# Autodesk Inventor assembly: Z-Axis
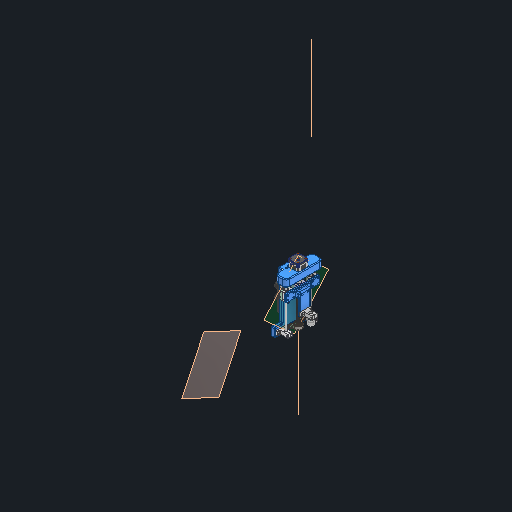
[picture p0: Inventor's stored thumbnail of the model, 512x512]
Saved by Autodesk Inventor 2027.1 (Build 311270010, 270A)
## iProperties
Created: 2026-10-04
Part Number: Z-Axis
Document SubType Name: Assembly
Designer: Ahmed
Author: Ahmed
## Documents named in this file (29)
- C:\Users\Ahmed\Desktop\Fall 26\Design 1 Repo\MCT333_Design_of_Mechatronics_Systems_1\CAD\cartesian_robot_workspace\Z Axis\Z-Axis.iam
- C:\Users\Ahmed\Desktop\Fall 26\Design 1 Repo\MCT333_Design_of_Mechatronics_Systems_1\CAD\cartesian_robot_workspace\Z Axis\V-Pulley.ipt
- C:\Users\Ahmed\Desktop\Fall 26\Design 1 Repo\MCT333_Design_of_Mechatronics_Systems_1\CAD\cartesian_robot_workspace\Z Axis\VSoltGantrySetAllSizes\VSoltGantrySetAllSizes\40mm Gantry Set universal\127x88 Gantry.ipt
- C:\Users\Ahmed\Desktop\Fall 26\Design 1 Repo\MCT333_Design_of_Mechatronics_Systems_1\CAD\cartesian_robot_workspace\Z Axis\sk8-linear-shaft-support-8mm-1.snapshot.1\SK8 Linear Shaft Support, 8mm v4\SK8 Linear Shaft Support, 8mm v4.ipt
- C:\Users\Ahmed\Desktop\Fall 26\Design 1 Repo\MCT333_Design_of_Mechatronics_Systems_1\CAD\cartesian_robot_workspace\Z Axis\scs8uu-linear-bearing-block-8mm-shaft-1.snapshot.1\SCS8UU Block, Linear Bearing, 8mm Shaft v4\SCS8UU Block, Linear Bearing, 8mm.ipt
- C:\Users\Ahmed\Desktop\Fall 26\Design 1 Repo\MCT333_Design_of_Mechatronics_Systems_1\CAD\cartesian_robot_workspace\Z Axis\shf10-shf8-linear-shaft-support-1.snapshot.6\SHF8\SHF8.ipt
- C:\Users\Ahmed\Desktop\Fall 26\Design 1 Repo\MCT333_Design_of_Mechatronics_Systems_1\CAD\cartesian_robot_workspace\Z Axis\KP08 Pillow block bearing 08mm diameter\KP08 Pillow block bearing 08mm diameter.ipt
- C:\Users\Ahmed\Desktop\Fall 26\Design 1 Repo\MCT333_Design_of_Mechatronics_Systems_1\CAD\cartesian_robot_workspace\Z Axis\nema-17-40mm-stepper-motor-1.snapshot.22\17HM15-0904S\17HM15-0904S\17HM15-0904S.ipt
- C:\Users\Ahmed\Desktop\Fall 26\Design 1 Repo\MCT333_Design_of_Mechatronics_Systems_1\CAD\cartesian_robot_workspace\Z Axis\aluminum-flexible-shaft-coupling-5mm-x-8mm-1.snapshot.1\Flexible Shaft Coupling 5mm to 8mm\Flexible_Shaft_Coupling_5_to_8mm v7.ipt
- C:\Users\Ahmed\Desktop\Fall 26\Design 1 Repo\MCT333_Design_of_Mechatronics_Systems_1\CAD\cartesian_robot_workspace\Z Axis\Z Bracket.ipt
- C:\Users\Ahmed\Desktop\Fall 26\Design 1 Repo\MCT333_Design_of_Mechatronics_Systems_1\CAD\cartesian_robot_workspace\Z Axis\tr8x8-4-8mm-4-start-lead-screw-1.snapshot.6\Trapezoidal lead screw tr8x8-4\Trapezoidal lead screw tr8x8-4.ipt
- C:\Users\Ahmed\Desktop\Fall 26\Design 1 Repo\MCT333_Design_of_Mechatronics_Systems_1\CAD\cartesian_robot_workspace\Z Axis\t8_nut_housing\t8_nut_housing.ipt
- C:\Users\Ahmed\Desktop\Fall 26\Design 1 Repo\MCT333_Design_of_Mechatronics_Systems_1\CAD\cartesian_robot_workspace\Z Axis\shf10-shf8-linear-shaft-support-1.snapshot.6\SHF8\SHF8_MIR.ipt
- C:\Users\Ahmed\Desktop\Fall 26\Design 1 Repo\MCT333_Design_of_Mechatronics_Systems_1\CAD\cartesian_robot_workspace\Z Axis\Linear Guide Rods.ipt
- C:\Users\Ahmed\Documents\Inventor\Content Center Files\R2027\en-US\ISO 4032(2)\ISO 4032 - M5 - ISO.ipt
- C:\Users\Ahmed\Documents\Inventor\Content Center Files\R2027\en-US\ISO 4762(2)\ISO 4762 - M5 x 16ISO.ipt
- C:\Users\Ahmed\Desktop\Fall 26\Design 1 Repo\MCT333_Design_of_Mechatronics_Systems_1\CAD\cartesian_robot_workspace\Z Axis\Bearing Spacer.ipt
- C:\Users\Ahmed\Desktop\Fall 26\Design 1 Repo\MCT333_Design_of_Mechatronics_Systems_1\CAD\cartesian_robot_workspace\Z Axis\Insert M5 D7 L9.5mm\Insert M5 D7 L9.5mm.ipt
- C:\Users\Ahmed\Desktop\Fall 26\Design 1 Repo\MCT333_Design_of_Mechatronics_Systems_1\CAD\cartesian_robot_workspace\Z Axis\M4 Insert\M4 Insert.ipt
- C:\Users\Ahmed\Documents\Inventor\Content Center Files\R2027\en-US\ISO 4762(2)\ISO 4762 - M5 x 20ISO.ipt
- C:\Users\Ahmed\Desktop\Fall 26\Design 1 Repo\MCT333_Design_of_Mechatronics_Systems_1\CAD\cartesian_robot_workspace\Z Axis\ISO 4762 - M5 x 16ISO.ipt
- C:\Users\Ahmed\Desktop\Fall 26\Design 1 Repo\MCT333_Design_of_Mechatronics_Systems_1\CAD\cartesian_robot_workspace\Z Axis\Linear Bearing Spacer.ipt
- C:\Users\Ahmed\Desktop\Fall 26\Design 1 Repo\MCT333_Design_of_Mechatronics_Systems_1\CAD\cartesian_robot_workspace\Z Axis\T8 nut\T8 nut.ipt
- C:\Users\Ahmed\Documents\Inventor\Content Center Files\R2027\en-US\ISO 4762(2)\ISO 4762 - M3 x 12ISO.ipt
- C:\Users\Ahmed\Desktop\Fall 26\Design 1 Repo\MCT333_Design_of_Mechatronics_Systems_1\CAD\cartesian_robot_workspace\Z Axis\NO-NC Bump Switch\NO-NC Bump Switch.ipt
- C:\Users\Ahmed\Desktop\Fall 26\Design 1 Repo\MCT333_Design_of_Mechatronics_Systems_1\CAD\cartesian_robot_workspace\Z Axis\Limit Switch Spacer.ipt
- C:\Users\Ahmed\Desktop\Fall 26\Design 1 Repo\MCT333_Design_of_Mechatronics_Systems_1\CAD\cartesian_robot_workspace\Z Axis\SK12 SHAFT HOLDER\SK12 SHAFT HOLDER.ipt
- C:\Users\Ahmed\Desktop\Fall 26\Design 1 Repo\MCT333_Design_of_Mechatronics_Systems_1\CAD\cartesian_robot_workspace\Z Axis\Suction Cup Fixation.ipt
- C:\Users\Ahmed\Desktop\Fall 26\Design 1 Repo\MCT333_Design_of_Mechatronics_Systems_1\CAD\cartesian_robot_workspace\Z Axis\Suction\Suction.iam
## Components (70 placed, 27 different names)
1. 127x88 Gantry:1 — Insert:2, Insert:4, Mate:2, Mate:3, Mate:4, Insert:27, Insert:28, Mate:89, Mate:93, Mate:94, Mate:95, Mate:97, Mate:98, Mate:99, Mate:100, Flush:18, Flush:19, Flush:20
2. V-Pulley:4 — Insert:27
3. V-Pulley:3 — Insert:28
4. V-Pulley:2 — Insert:4
5. V-Pulley:1 — Insert:2
6. ISO 4032 M5:13 — Mate:96, Mate:97
7. ISO 4032 M5:20 — Mate:98, Mate:102
8. ISO 4032 M5:19 — Mate:99, Mate:101
9. ISO 4032 M5:18 — Mate:100, Mate:103
10. ISO 4762 M5 x 20:9 — Insert:29, Mate:96
11. ISO 4762 M5 x 20:12 — Insert:32, Mate:101
12. ISO 4762 M5 x 20:10 — Insert:31, Mate:102
13. ISO 4762 M5 x 20:11 — Insert:30, Mate:103
14. ISO 4032 M5:17 — Mate:88, Mate:89
15. ISO 4032 M5:16 — Mate:90, Mate:95
16. ISO 4032 M5:15 — Mate:91, Mate:94
17. ISO 4032 M5:14 — Mate:92, Mate:93
18. ISO 4762 M5 x 20:7 — Insert:17, Mate:92
19. ISO 4762 M5 x 20:8 — Insert:18, Mate:91
20. ISO 4762 M5 x 20:5 — Insert:15, Mate:88
21. ISO 4762 M5 x 20:6 — Insert:16, Mate:90
22. Z Bracket:1 — Mate:2, Mate:3, Mate:4, Mate:7, Mate:10, Angle:1, Mate:18, Mate:19, Mate:20, Mate:21, Mate:22, Mate:26, Mate:27, Mate:28, Mate:30, Mate:32, Angle:6, Mate:38, Angle:7, Mate:41, Mate:42, Mate:43, Mate:44, Mate:45, Mate:47, Mate:48, Mate:49, Mate:50, Mate:51, Mate:52, Mate:53, Flush:7, Mate:54, Flush:8, Mate:55, Flush:9, Mate:56, Flush:10, Mate:57, Mate:58, Mate:59, Mate:60, Flush:11, Flush:12, Flush:13, Flush:14, Mate:61, Mate:62, Flush:15, Flush:16, Insert:15, Insert:16, Insert:17, Insert:18, Insert:23, Insert:24, Insert:25, Insert:26, Insert:29, Insert:30, Insert:31, Insert:32, Flush:17, Mate:104, Mate:105, Mate:106, Mate:116, Mate:117
23. Bearing Spacer:1 — Mate:50, Mate:51, Mate:52
24. Insert M5 D7 L9.5mm:1 — Mate:53, Flush:7
25. Insert M5 D7 L9.5mm:2 — Mate:54, Flush:8
26. Insert M5 D7 L9.5mm:3 — Mate:55, Flush:9
27. Insert M5 D7 L9.5mm:4 — Mate:56, Flush:10
28. Insert M5 D7 L9.5mm:5 — Mate:58, Flush:13
29. Insert M5 D7 L9.5mm:6 — Mate:57, Flush:14
30. Insert M5 D7 L9.5mm:7 — Mate:59, Flush:11
31. Insert M5 D7 L9.5mm:8 — Mate:60, Flush:12
32. M4 Insert:1 — Mate:61, Flush:16
33. M4 Insert:2 — Mate:62, Flush:15
34. 17HM15-0904S:1 — Mate:7, Mate:8, Mate:116, Mate:117
35. Flexible_Shaft_Coupling_5_to_8mm v7:1 — Mate:8, Mate:10, Mate:12, Mate:33, Mate:63, Tangent:13
36. ISO 4762 M5 x 16:5 — Insert:23
37. ISO 4762 M5 x 16:6 — Insert:24
38. ISO 4762 M5 x 16:7 — Insert:25
39. ISO 4762 M5 x 16:8 — Insert:26
40. Linear Bearing Spacer:2 — Mate:75, Mate:76, Mate:77, Mate:108
41. SCS8UU Block, Linear Bearing, 8mm:2 — Mate:35, Angle:4, Flush:6, Mate:75, Mate:76, Mate:77
42. SK8 Linear Shaft Support, 8mm v4:1 — Mate:18, Mate:29, Mate:41, Mate:42, Insert:9, Insert:10
43. SHF8:1 — Mate:19, Mate:20, Mate:21, Mate:22, Insert:5, Insert:6
44. Linear Guide Rods:2 — Mate:29, Mate:30, Mate:35
45. ISO 4762 M5 x 20:1 — Insert:5
46. ISO 4762 M5 x 20:2 — Insert:6
47. ISO 4762 M5 x 16:1 — Insert:9
48. ISO 4762 M5 x 16:2 — Insert:10
49. KP08 Pillow block bearing 08mm diameter:1 — Mate:47, Mate:48, Mate:49, Insert:13, Insert:14
50. Trapezoidal lead screw tr8x8-4:1 — Mate:12, Mate:13, Mate:33
51. t8_nut_housing:1 — Mate:13, Angle:1, Angle:4, Angle:5, Flush:5, Flush:6, Mate:63, Mate:81, Mate:82, Mate:83, Mate:107, Mate:109
52. ISO 4762 M5 x 16:1 — Insert:13
53. ISO 4762 M5 x 16:2 — Insert:14
54. T8 nut:1 — Mate:81, Mate:82, Mate:83, Mate:84, Mate:85, Mate:86, Mate:87
55. ISO 4762 M3 x 12:4 — Mate:84, Mate:87
56. ISO 4762 M3 x 12:5 — Mate:85, Mate:86
57. SCS8UU Block, Linear Bearing, 8mm:1 — Mate:34, Angle:5, Flush:5, Mate:78, Mate:79, Mate:80
58. SHF8_MIR:1 — Mate:26, Mate:27, Mate:28, Insert:7, Insert:8
59. Linear Guide Rods:1 — Mate:32, Mate:34, Mate:36, Mate:46
60. SK8 Linear Shaft Support, 8mm v4:2 — Mate:43, Mate:44, Mate:45, Mate:46, Insert:11, Insert:12
61. ISO 4762 M5 x 20:3 — Insert:7
62. ISO 4762 M5 x 20:4 — Insert:8
63. ISO 4762 M5 x 16:3 — Insert:12
64. ISO 4762 M5 x 16:4 — Insert:11
65. Linear Bearing Spacer:1 — Mate:78, Mate:79, Mate:80
66. NO-NC Bump Switch:1 — Tangent:13, Flush:17, Mate:115
67. Limit Switch Spacer:1 — Mate:104, Mate:105, Mate:106, Mate:115
68. Suction:1 [sub-assembly] — Mate:118, Mate:119
69. SK12 SHAFT HOLDER:1 — Mate:110, Mate:111, Mate:112, Mate:118, Mate:119
70. Suction Cup Fixation:1 — Mate:107, Mate:108, Mate:109, Mate:110, Mate:111, Mate:112
## Relationships (140: Mate 92, Insert 26, Flush 16, Angle 5, Tangent 1)
- Insert:2: 127x88 Gantry:1 ↔ V-Pulley:1
- Insert:4: 127x88 Gantry:1 ↔ V-Pulley:2
- Mate:2: 127x88 Gantry:1 ↔ Z Bracket:1
- Mate:3: 127x88 Gantry:1 ↔ Z Bracket:1
- Mate:4: 127x88 Gantry:1 ↔ Z Bracket:1
- Mate:7: Z Bracket:1 ↔ 17HM15-0904S:1
- Mate:8: 17HM15-0904S:1 ↔ Flexible_Shaft_Coupling_5_to_8mm v7:1
- Mate:10: Z Bracket:1 ↔ Flexible_Shaft_Coupling_5_to_8mm v7:1
- Mate:12: Flexible_Shaft_Coupling_5_to_8mm v7:1 ↔ Trapezoidal lead screw tr8x8-4:1
- Mate:13: Trapezoidal lead screw tr8x8-4:1 ↔ t8_nut_housing:1
- Angle:1 (0 deg): Z Bracket:1 ↔ t8_nut_housing:1
- Mate:18: Z Bracket:1 ↔ SK8 Linear Shaft Support, 8mm v4:1
- Mate:19: Z Bracket:1 ↔ SHF8:1
- Mate:20: Z Bracket:1 ↔ SHF8:1
- Mate:21: Z Bracket:1 ↔ SHF8:1
- Mate:22: Z Bracket:1 ↔ SHF8:1
- Mate:26: Z Bracket:1 ↔ SHF8_MIR:1
- Mate:27: Z Bracket:1 ↔ SHF8_MIR:1
- Mate:28: Z Bracket:1 ↔ SHF8_MIR:1
- Mate:29: SK8 Linear Shaft Support, 8mm v4:1 ↔ Linear Guide Rods:2
- Mate:30: Z Bracket:1 ↔ Linear Guide Rods:2
- Mate:32: Z Bracket:1 ↔ Linear Guide Rods:1
- Mate:33: Flexible_Shaft_Coupling_5_to_8mm v7:1 ↔ Trapezoidal lead screw tr8x8-4:1
- Mate:34: SCS8UU Block, Linear Bearing, 8mm:1 ↔ Linear Guide Rods:1
- Mate:35: SCS8UU Block, Linear Bearing, 8mm:2 ↔ Linear Guide Rods:2
- Angle:4 (0 deg): SCS8UU Block, Linear Bearing, 8mm:2 ↔ t8_nut_housing:1
- Angle:5 (0 deg): t8_nut_housing:1 ↔ SCS8UU Block, Linear Bearing, 8mm:1
- Mate:36: Linear Guide Rods:1
- Mate:37
- Angle:6 (90 deg): Z Bracket:1
- Mate:38: Z Bracket:1
- Mate:39
- Angle:7 (90 deg): Z Bracket:1
- Flush:5: t8_nut_housing:1 ↔ SCS8UU Block, Linear Bearing, 8mm:1
- Flush:6: SCS8UU Block, Linear Bearing, 8mm:2 ↔ t8_nut_housing:1
- Mate:41: Z Bracket:1 ↔ SK8 Linear Shaft Support, 8mm v4:1
- Mate:42: Z Bracket:1 ↔ SK8 Linear Shaft Support, 8mm v4:1
- Mate:43: Z Bracket:1 ↔ SK8 Linear Shaft Support, 8mm v4:2
- Mate:44: Z Bracket:1 ↔ SK8 Linear Shaft Support, 8mm v4:2
- Mate:45: Z Bracket:1 ↔ SK8 Linear Shaft Support, 8mm v4:2
- Mate:46: Linear Guide Rods:1 ↔ SK8 Linear Shaft Support, 8mm v4:2
- Mate:47: Z Bracket:1 ↔ KP08 Pillow block bearing 08mm diameter:1
- Mate:48: Z Bracket:1 ↔ KP08 Pillow block bearing 08mm diameter:1
- Mate:49: Z Bracket:1 ↔ KP08 Pillow block bearing 08mm diameter:1
- Mate:50: Z Bracket:1 ↔ Bearing Spacer:1
- Mate:51: Z Bracket:1 ↔ Bearing Spacer:1
- Mate:52: Z Bracket:1 ↔ Bearing Spacer:1
- Mate:53: Z Bracket:1 ↔ Insert M5 D7 L9.5mm:1
- Flush:7: Z Bracket:1 ↔ Insert M5 D7 L9.5mm:1
- Mate:54: Z Bracket:1 ↔ Insert M5 D7 L9.5mm:2
- Flush:8: Z Bracket:1 ↔ Insert M5 D7 L9.5mm:2
- Mate:55: Z Bracket:1 ↔ Insert M5 D7 L9.5mm:3
- Flush:9: Z Bracket:1 ↔ Insert M5 D7 L9.5mm:3
- Mate:56: Z Bracket:1 ↔ Insert M5 D7 L9.5mm:4
- Flush:10: Z Bracket:1 ↔ Insert M5 D7 L9.5mm:4
- Mate:57: Z Bracket:1 ↔ Insert M5 D7 L9.5mm:6
- Mate:58: Z Bracket:1 ↔ Insert M5 D7 L9.5mm:5
- Mate:59: Z Bracket:1 ↔ Insert M5 D7 L9.5mm:7
- Mate:60: Z Bracket:1 ↔ Insert M5 D7 L9.5mm:8
- Flush:11: Z Bracket:1 ↔ Insert M5 D7 L9.5mm:7
- Flush:12: Z Bracket:1 ↔ Insert M5 D7 L9.5mm:8
- Flush:13: Z Bracket:1 ↔ Insert M5 D7 L9.5mm:5
- Flush:14: Z Bracket:1 ↔ Insert M5 D7 L9.5mm:6
- Mate:61: Z Bracket:1 ↔ M4 Insert:1
- Mate:62: Z Bracket:1 ↔ M4 Insert:2
- Flush:15: Z Bracket:1 ↔ M4 Insert:2
- Flush:16: Z Bracket:1 ↔ M4 Insert:1
- Insert:5: SHF8:1 ↔ ISO 4762 M5 x 20:1
- Insert:6: SHF8:1 ↔ ISO 4762 M5 x 20:2
- Insert:7: SHF8_MIR:1 ↔ ISO 4762 M5 x 20:3
- Insert:8: SHF8_MIR:1 ↔ ISO 4762 M5 x 20:4
- Insert:9: SK8 Linear Shaft Support, 8mm v4:1 ↔ ISO 4762 M5 x 16:1
- Insert:10: SK8 Linear Shaft Support, 8mm v4:1 ↔ ISO 4762 M5 x 16:2
- Insert:11: SK8 Linear Shaft Support, 8mm v4:2 ↔ ISO 4762 M5 x 16:4
- Insert:12: SK8 Linear Shaft Support, 8mm v4:2 ↔ ISO 4762 M5 x 16:3
- Insert:13: KP08 Pillow block bearing 08mm diameter:1 ↔ ISO 4762 M5 x 16:1
- Insert:14: KP08 Pillow block bearing 08mm diameter:1 ↔ ISO 4762 M5 x 16:2
- Insert:15: ISO 4762 M5 x 20:5 ↔ Z Bracket:1
- Insert:16: ISO 4762 M5 x 20:6 ↔ Z Bracket:1
- Insert:17: ISO 4762 M5 x 20:7 ↔ Z Bracket:1
- Insert:18: ISO 4762 M5 x 20:8 ↔ Z Bracket:1
- Insert:23: Z Bracket:1 ↔ ISO 4762 M5 x 16:5
- Insert:24: Z Bracket:1 ↔ ISO 4762 M5 x 16:6
- Insert:25: Z Bracket:1 ↔ ISO 4762 M5 x 16:7
- Insert:26: Z Bracket:1 ↔ ISO 4762 M5 x 16:8
- Mate:63: Flexible_Shaft_Coupling_5_to_8mm v7:1 ↔ t8_nut_housing:1
- Mate:75: Linear Bearing Spacer:2 ↔ SCS8UU Block, Linear Bearing, 8mm:2
- Mate:76: Linear Bearing Spacer:2 ↔ SCS8UU Block, Linear Bearing, 8mm:2
- Mate:77: Linear Bearing Spacer:2 ↔ SCS8UU Block, Linear Bearing, 8mm:2
- Mate:78: SCS8UU Block, Linear Bearing, 8mm:1 ↔ Linear Bearing Spacer:1
- Mate:79: SCS8UU Block, Linear Bearing, 8mm:1 ↔ Linear Bearing Spacer:1
- Mate:80: SCS8UU Block, Linear Bearing, 8mm:1 ↔ Linear Bearing Spacer:1
- Insert:27: 127x88 Gantry:1 ↔ V-Pulley:4
- Insert:28: 127x88 Gantry:1 ↔ V-Pulley:3
- Mate:81: t8_nut_housing:1 ↔ T8 nut:1
- Mate:82: t8_nut_housing:1 ↔ T8 nut:1
- Mate:83: t8_nut_housing:1 ↔ T8 nut:1
- Mate:84: T8 nut:1 ↔ ISO 4762 M3 x 12:4
- Mate:85: T8 nut:1 ↔ ISO 4762 M3 x 12:5
- Mate:86: T8 nut:1 ↔ ISO 4762 M3 x 12:5
- Mate:87: T8 nut:1 ↔ ISO 4762 M3 x 12:4
- Mate:88: ISO 4032 M5:17 ↔ ISO 4762 M5 x 20:5
- Mate:89: 127x88 Gantry:1 ↔ ISO 4032 M5:17
- Mate:90: ISO 4032 M5:16 ↔ ISO 4762 M5 x 20:6
- Mate:91: ISO 4032 M5:15 ↔ ISO 4762 M5 x 20:8
- Mate:92: ISO 4032 M5:14 ↔ ISO 4762 M5 x 20:7
- Mate:93: 127x88 Gantry:1 ↔ ISO 4032 M5:14
- Mate:94: 127x88 Gantry:1 ↔ ISO 4032 M5:15
- Mate:95: 127x88 Gantry:1 ↔ ISO 4032 M5:16
- Insert:29: ISO 4762 M5 x 20:9 ↔ Z Bracket:1
- Insert:30: ISO 4762 M5 x 20:11 ↔ Z Bracket:1
- Insert:31: ISO 4762 M5 x 20:10 ↔ Z Bracket:1
- Insert:32: ISO 4762 M5 x 20:12 ↔ Z Bracket:1
- Mate:96: ISO 4032 M5:13 ↔ ISO 4762 M5 x 20:9
- Mate:97: 127x88 Gantry:1 ↔ ISO 4032 M5:13
- Mate:98: 127x88 Gantry:1 ↔ ISO 4032 M5:20
- Mate:99: 127x88 Gantry:1 ↔ ISO 4032 M5:19
- Mate:100: 127x88 Gantry:1 ↔ ISO 4032 M5:18
- Mate:101: ISO 4032 M5:19 ↔ ISO 4762 M5 x 20:12
- Mate:102: ISO 4032 M5:20 ↔ ISO 4762 M5 x 20:10
- Mate:103: ISO 4032 M5:18 ↔ ISO 4762 M5 x 20:11
- Tangent:13 (-10 mm): Flexible_Shaft_Coupling_5_to_8mm v7:1 ↔ NO-NC Bump Switch:1
- Flush:17 (9 mm): Z Bracket:1 ↔ NO-NC Bump Switch:1
- Mate:104: Z Bracket:1 ↔ Limit Switch Spacer:1
- Mate:105: Z Bracket:1 ↔ Limit Switch Spacer:1
- Mate:106: Z Bracket:1 ↔ Limit Switch Spacer:1
- Mate:107: t8_nut_housing:1 ↔ Suction Cup Fixation:1
- Mate:108: Linear Bearing Spacer:2 ↔ Suction Cup Fixation:1
- Mate:109: t8_nut_housing:1 ↔ Suction Cup Fixation:1
- Mate:110: SK12 SHAFT HOLDER:1 ↔ Suction Cup Fixation:1
- Mate:111: SK12 SHAFT HOLDER:1 ↔ Suction Cup Fixation:1
- Mate:112: SK12 SHAFT HOLDER:1 ↔ Suction Cup Fixation:1
- Mate:115: NO-NC Bump Switch:1 ↔ Limit Switch Spacer:1
- Mate:116: Z Bracket:1 ↔ 17HM15-0904S:1
- Mate:117: Z Bracket:1 ↔ 17HM15-0904S:1
- Flush:18: 127x88 Gantry:1
- Flush:19: 127x88 Gantry:1
- Flush:20: 127x88 Gantry:1
- Mate:118: Suction:1 ↔ SK12 SHAFT HOLDER:1
- Mate:119: Suction:1 ↔ SK12 SHAFT HOLDER:1
## Named parameters: M3_Insert_Nut_Hole = 4 mm, M4_Insert_Nut_Hole = 1 mm, M5_Insert_Nut_Hole = 5.7 mm
